# Autodesk Inventor assembly: Robot
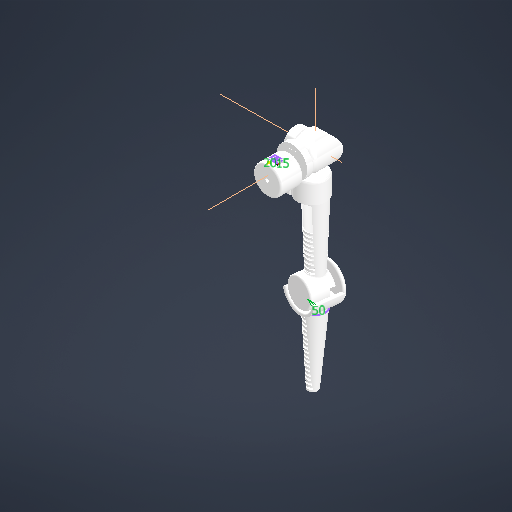
[picture p0: Inventor's stored thumbnail of the model, 512x512]
Saved by Autodesk Inventor 2026 (Build 300175000, 175)
## iProperties
Created: 2026-08-10
Part Number: Robot
Document SubType Name: Assembly
Designer: arnav
Author: arnav
## Documents named in this file (8)
- C:\Stored Data\OttoLink\CAD\Printing\.ipt\Robot.iam
- C:\Stored Data\OttoLink\CAD\Printing\.ipt\PitchMotorHolder.ipt
- C:\Stored Data\OttoLink\CAD\Downloaded\DS3225MG 25KG.ipt
- C:\Stored Data\OttoLink\CAD\Main\Circular Servo Horn.ipt
- C:\Stored Data\OttoLink\CAD\Printing\.ipt\RollServoMount.ipt
- C:\Stored Data\OttoLink\CAD\Printing\.ipt\YawMotorHolder.ipt
- C:\Stored Data\OttoLink\CAD\Printing\.ipt\UpperArm.ipt
- C:\Stored Data\OttoLink\CAD\Printing\.ipt\LowArm.ipt
## Components (13 placed, 13 different names)
1. PitchMotorHolder:1 — Insert:2, Insert:15
2. PitchMotor — Insert:2, Insert:15, Insert:23, Mate:3
3. PitchHorn — Insert:21, Insert:22, Insert:23, Angle:1
4. RollServoMount:1 — Insert:10, Insert:11, Insert:21, Insert:22
5. RollMotor — Mate:1, Insert:10, Insert:11, Insert:26
6. RollHorn — Insert:24, Insert:25, Insert:26
7. YawMotor — Mate:2, Insert:19, Insert:20, Insert:27
8. YawMotorHolder — Insert:19, Insert:20, Insert:24, Insert:25
9. YawHorn — Insert:27, Insert:28, Insert:29
10. UpperArm:1 — Insert:28, Insert:29, Insert:30, Insert:31
11. ElbowMotor — Insert:30, Insert:31, Insert:34
12. Elbow Horn — Insert:32, Insert:33, Insert:34
13. LowArm:1 — Insert:32, Insert:33
## Relationships (24: Insert 20, Mate 3, Angle 1)
- Insert:2: PitchMotorHolder:1 ↔ PitchMotor
- Mate:1: RollMotor
- Insert:10: RollServoMount:1 ↔ RollMotor
- Insert:11: RollServoMount:1 ↔ RollMotor
- Insert:15: PitchMotorHolder:1 ↔ PitchMotor
- Mate:2: YawMotor
- Insert:19: YawMotor ↔ YawMotorHolder
- Insert:20: YawMotor ↔ YawMotorHolder
- Insert:21: PitchHorn ↔ RollServoMount:1
- Insert:22: PitchHorn ↔ RollServoMount:1
- Insert:23 (-3.5 mm): PitchMotor ↔ PitchHorn
- Mate:3: PitchMotor
- Insert:24: RollHorn ↔ YawMotorHolder
- Insert:25: RollHorn ↔ YawMotorHolder
- Insert:26: RollMotor ↔ RollHorn
- Angle:1 (0 deg): PitchHorn
- Insert:27 (-3.5 mm): YawMotor ↔ YawHorn
- Insert:28: YawHorn ↔ UpperArm:1
- Insert:29: YawHorn ↔ UpperArm:1
- Insert:30: UpperArm:1 ↔ ElbowMotor
- Insert:31: UpperArm:1 ↔ ElbowMotor
- Insert:32: Elbow Horn ↔ LowArm:1
- Insert:33: Elbow Horn ↔ LowArm:1
- Insert:34: ElbowMotor ↔ Elbow Horn
